# Autodesk Inventor assembly: Assembly3
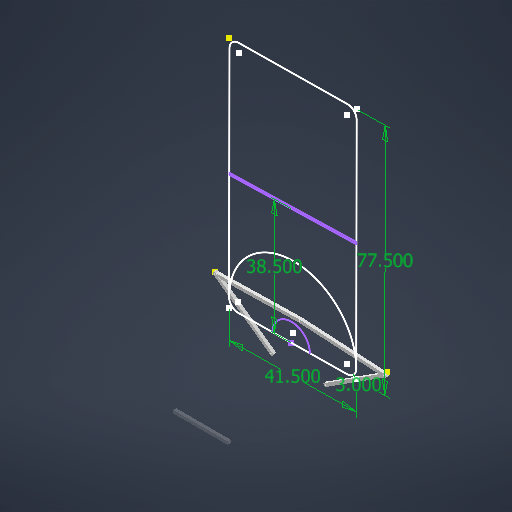
[picture p0: Inventor's stored thumbnail of the model, 512x512]
Saved by Autodesk Inventor 2027 (Build 310192000, 192)
## iProperties
Created: 2026-11-12
Part Number: Assembly3
Document SubType Name: Assembly
Designer: lukeg
Author: lukeg
## Documents named in this file (5)
- C:\Users\lukeg\Documents\github\AirHockeyRobot\ACAD\Assembly3.iam
- C:\Users\lukeg\OneDrive\Desktop\ACAD\Part2.ipt
- C:\Users\lukeg\OneDrive\Desktop\ACAD\Part7.ipt
- C:\Users\lukeg\Documents\github\AirHockeyRobot\ACAD\AirHockeyTableTop.ipt
- C:\Users\lukeg\Documents\github\AirHockeyRobot\ACAD\forearm.ipt
## Components (6 placed, 4 different names)
1. Part2:2 — Mate:1, Rotational:2
2. Part2:4 — Mate:2, Rotational:1
3. Part7:1 — Mate:1, Mate:2
4. AirHockeyTableTop:1
5. forearm:1 — Rotational:1, Rotational:3
6. forearm:2 — Rotational:2, Rotational:3
## Relationships (5: RevoluteJoint 3, Mate 2)
- Mate:1: Part2:2 ↔ Part7:1
- Mate:2: Part2:4 ↔ Part7:1
- Rotational:1 [RevoluteJoint]: Part2:4 ↔ forearm:1
- Rotational:2 [RevoluteJoint]: Part2:2 ↔ forearm:2
- Rotational:3 [RevoluteJoint]: forearm:1 ↔ forearm:2
